# Autodesk Inventor assembly: 遥控器装配体
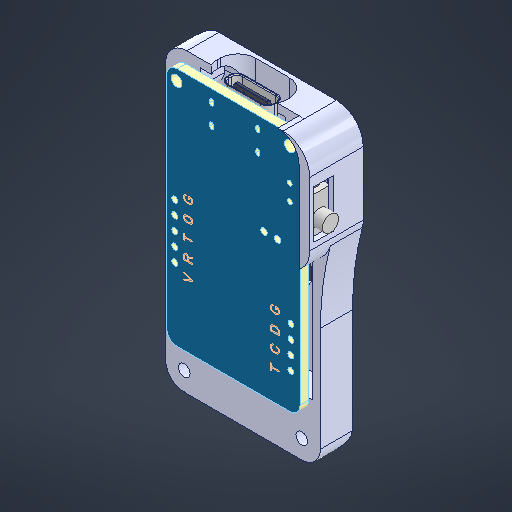
[picture p0: Inventor's stored thumbnail of the model, 512x512]
Saved by Autodesk Inventor 2025 (Build 290162000, 162)
## iProperties
Created: 2025-11-04
Part Number: 遥控器装配体
Document SubType Name: Assembly
Designer: HZD
Author: HZD
## Documents named in this file (4)
- D:\2 B Mechanical design\Bright\二代遥控器\遥控器装配体.iam
- D:\2 B Mechanical design\Bright\更新图纸\灯板更新\遥控器.ipt
- D:\2 B Mechanical design\Bright\二代遥控器\遥控板PCB.iam
- D:\2 B Mechanical design\Bright\二代遥控器\开关.ipt
## Components (3 placed, 3 different names)
1. 遥控器:1 — 配合:1, 配合:2, 配合:3, 配合:4
2. 遥控板PCB:1 [sub-assembly] — 配合:1, 配合:2, 配合:3, 配合:5
3. 开关:1 — 配合:4, 配合:5
## Relationships (5: Mate 5)
- 配合:1 [Mate]: 遥控器:1 ↔ 遥控板PCB:1
- 配合:2 [Mate]: 遥控器:1 ↔ 遥控板PCB:1
- 配合:3 [Mate]: 遥控器:1 ↔ 遥控板PCB:1
- 配合:4 [Mate]: 遥控器:1 ↔ 开关:1
- 配合:5 [Mate]: 遥控板PCB:1 ↔ 开关:1
